# Autodesk Inventor assembly: Assy_power_module
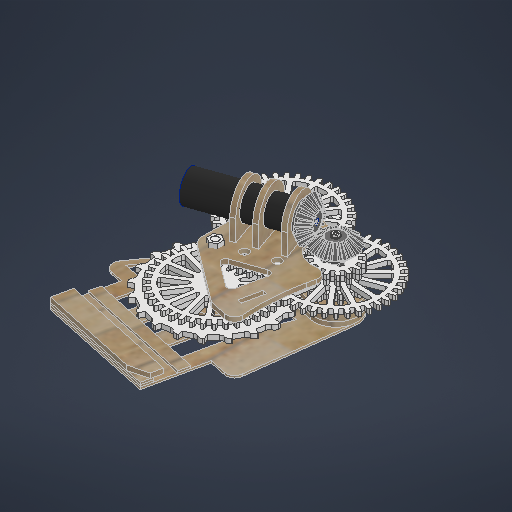
[picture p0: Inventor's stored thumbnail of the model, 512x512]
Saved by Autodesk Inventor 2027.1 (Build 311270010, 270A)
## iProperties
Created: 2025-09-27
Part Number: Assy_power_module
Document SubType Name: Assembly
Designer: hibik
Author: hibik
## Documents named in this file (10)
- D:\model\D2_Conveyor_2026\power_module\Assy_power_module.iam
- D:\model\D2_Conveyor_2026\power_module\gear_box.iam
- D:\model\D2_Conveyor_2026\power_module\motor.ipt
- D:\model\D2_Conveyor_2026\power_module\gear_plate_cover.ipt
- D:\model\D2_Conveyor_2026\power_module\motor_setter_middle.ipt
- D:\model\D2_Conveyor_2026\power_module\motor_setter_front.ipt
- D:\model\D2_Conveyor_2026\power_module\motor_setter_fixer.ipt
- D:\model\D2_Conveyor_2026\power_module\M3_15_crown_in.ipt
- D:\model\D2_Conveyor_2026\Bearing\Spacer_for_Shaft_Final_mid.ipt
- D:\model\ConQuester\SemiAutonomous\Body\Spacer_Shaft_Second_mid.ipt
## Components (9 placed, 9 different names)
1. gear_box:1 [sub-assembly] — メイト:11, フラッシュ:6, フラッシュ:7, フラッシュ:8, フラッシュ:9, フラッシュ:10, メイト:21, フラッシュ:11
2. gear_plate_cover:1 — メイト:5, フラッシュ:1, フラッシュ:2, フラッシュ:3, メイト:8, メイト:9, メイト:10, メイト:11, フラッシュ:6, フラッシュ:10, メイト:21
3. M3_15_crown_in:1 — 回転:1
4. motor_setter_fixer:1 — メイト:5, メイト:6, メイト:7, フラッシュ:1, フラッシュ:4, メイト:8, メイト:20
5. motor_setter_front:1 — フラッシュ:2, フラッシュ:4, フラッシュ:5, メイト:9
6. motor_setter_middle:1 — フラッシュ:3, フラッシュ:5, メイト:10
7. motor:1 — メイト:6, メイト:7, 回転:1, メイト:20
8. Spacer_for_Shaft_Final_mid:1 — フラッシュ:7, フラッシュ:8, フラッシュ:9
9. Spacer_Shaft_Second_mid:1 — フラッシュ:11
## Relationships (21: Flush 11, Mate 9, RevoluteJoint 1)
- メイト:5 [Mate]: gear_plate_cover:1 ↔ motor_setter_fixer:1
- メイト:6 [Mate]: motor_setter_fixer:1 ↔ motor:1
- メイト:7 [Mate]: motor_setter_fixer:1 ↔ motor:1
- フラッシュ:1 [Flush]: gear_plate_cover:1 ↔ motor_setter_fixer:1
- フラッシュ:2 [Flush]: gear_plate_cover:1 ↔ motor_setter_front:1
- フラッシュ:3 [Flush]: gear_plate_cover:1 ↔ motor_setter_middle:1
- フラッシュ:4 [Flush]: motor_setter_fixer:1 ↔ motor_setter_front:1
- フラッシュ:5 [Flush]: motor_setter_front:1 ↔ motor_setter_middle:1
- メイト:8 [Mate]: gear_plate_cover:1 ↔ motor_setter_fixer:1
- メイト:9 [Mate]: gear_plate_cover:1 ↔ motor_setter_front:1
- メイト:10 [Mate]: gear_plate_cover:1 ↔ motor_setter_middle:1
- メイト:11 [Mate]: gear_box:1 ↔ gear_plate_cover:1
- 回転:1 [RevoluteJoint]: M3_15_crown_in:1 ↔ motor:1
- メイト:20 [Mate]: motor_setter_fixer:1 ↔ motor:1
- フラッシュ:6 [Flush] (5 mm): gear_box:1 ↔ gear_plate_cover:1
- フラッシュ:7 [Flush]: gear_box:1 ↔ Spacer_for_Shaft_Final_mid:1
- フラッシュ:8 [Flush]: gear_box:1 ↔ Spacer_for_Shaft_Final_mid:1
- フラッシュ:9 [Flush]: gear_box:1 ↔ Spacer_for_Shaft_Final_mid:1
- フラッシュ:10 [Flush]: gear_box:1 ↔ gear_plate_cover:1
- メイト:21 [Mate]: gear_box:1 ↔ gear_plate_cover:1
- フラッシュ:11 [Flush]: gear_box:1 ↔ Spacer_Shaft_Second_mid:1
